# Autodesk Inventor assembly: Main
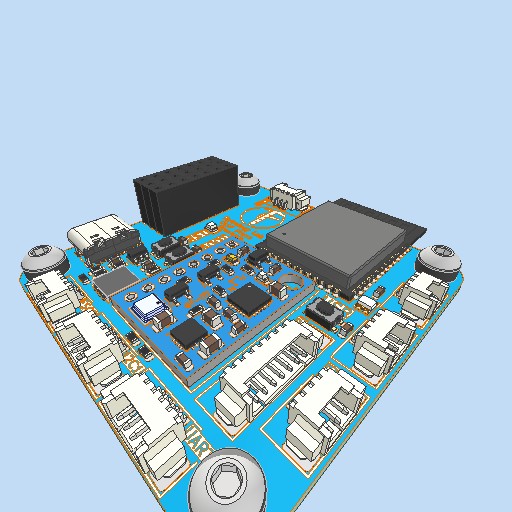
[picture p0: Inventor's stored thumbnail of the model, 512x512]
Saved by Autodesk Inventor 2026 (Build 300175000, 175)
## iProperties
Created: 2026-10-09
Part Number: Main
Document SubType Name: Assembly
Designer: Pacman Ng
Author: Pacman Ng
## Documents named in this file (3)
- D:\OneDrive_MSFT\Work\Drone_Research\3d_models\Calib_base\Main.iam
- D:\OneDrive_MSFT\Work\Drone_Research\3d_models\Calib_base\FC_v02.iam
- D:\OneDrive_MSFT\Work\Drone_Research\3d_models\Calib_base\Assembly1.iam
## Components (5 placed, 2 different names)
1. FC_v02:1 [sub-assembly] — Mate:1, Mate:2, Mate:3, Mate:4, Mate:5, Mate:6, Mate:7, Mate:8
2. Assembly1:1 [sub-assembly] — Mate:1, Mate:2
3. Assembly1:2 [sub-assembly] — Mate:3, Mate:4
4. Assembly1:3 [sub-assembly] — Mate:5, Mate:6
5. Assembly1:4 [sub-assembly] — Mate:7, Mate:8
## Relationships (8: Mate 8)
- Mate:1: FC_v02:1 ↔ Assembly1:1
- Mate:2: FC_v02:1 ↔ Assembly1:1
- Mate:3: FC_v02:1 ↔ Assembly1:2
- Mate:4: FC_v02:1 ↔ Assembly1:2
- Mate:5: FC_v02:1 ↔ Assembly1:3
- Mate:6: FC_v02:1 ↔ Assembly1:3
- Mate:7: FC_v02:1 ↔ Assembly1:4
- Mate:8: FC_v02:1 ↔ Assembly1:4
